# Autodesk Inventor assembly: 70-nipple-short
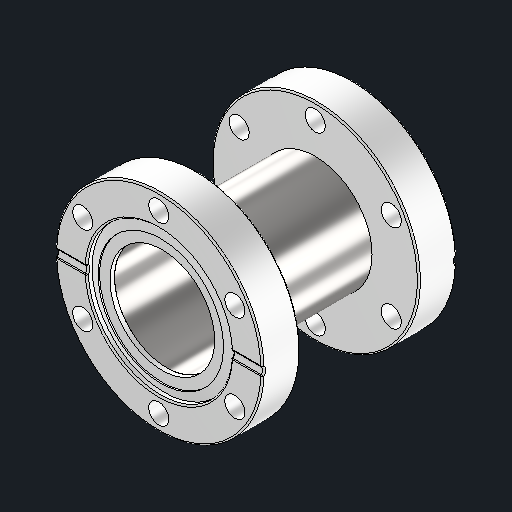
[picture p0: Inventor's stored thumbnail of the model, 512x512]
Saved by Autodesk Inventor 2027.1 (Build 311270010, 270A)
## iProperties
Created: 2019-11-13
Part Number: 70-nipple-short
Document SubType Name: Assembly
Designer: kuzmin
Mass: 565.151 g
Surface Area: 363.905 cm^2
Volume: 70.6439 cm^3
Density: 8 g/cm^3
Author: kuzmin
## Documents named in this file (3)
- C:\Users\queezz\Dropbox\Drawings\pihti-cad\Miura-membrane-experiments\70-nipple-short.iam
- C:\Users\queezz\Dropbox\Drawings\pihti-cad\Miura-membrane-experiments\nipple-pipe-to-membrane.ipt
- C:\Users\queezz\Dropbox\Drawings\pihti-cad\Miura-membrane-experiments\70-nipple-flange.ipt
## Components (3 placed, 2 different names)
1. 70-nipple-flange:1 — Mate:1, Mate:3, Mate:5
2. 70-nipple-flange:2 — Mate:2, Mate:4, Mate:5
3. nipple-pipe-to-membrane:1 — Mate:1, Mate:2, Mate:3, Mate:4
## Relationships (5: Mate 5)
- Mate:1: 70-nipple-flange:1 ↔ nipple-pipe-to-membrane:1
- Mate:2: 70-nipple-flange:2 ↔ nipple-pipe-to-membrane:1
- Mate:3: 70-nipple-flange:1 ↔ nipple-pipe-to-membrane:1
- Mate:4: 70-nipple-flange:2 ↔ nipple-pipe-to-membrane:1
- Mate:5 (-65 mm): 70-nipple-flange:1 ↔ 70-nipple-flange:2
